# Autodesk Inventor assembly: 4 CYLINDER ENGINE ASSEMBLY
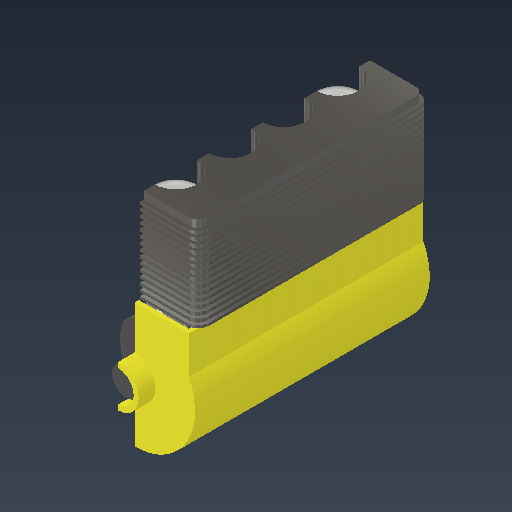
[picture p0: Inventor's stored thumbnail of the model, 512x512]
Saved by Autodesk Inventor 2026.1 (Build 301233020, 233B)
## iProperties
Created: 2026-10-10
Part Number: 4 CYLINDER ENGINE ASSEMBLY
Document SubType Name: Assembly
Designer: ADMIN
Author: ADMIN
## Documents named in this file (7)
- C:\Users\ADMIN\Desktop\4 cylinder Engine Design\4 CYLINDER ENGINE ASSEMBLY.iam
- C:\Users\ADMIN\Desktop\4 cylinder Engine Design\LOWER BLOCK.ipt
- C:\Users\ADMIN\Desktop\4 cylinder Engine Design\ENGINE BLOCK.ipt
- C:\Users\ADMIN\Desktop\4 cylinder Engine Design\CRANK SHAFT.ipt
- C:\Users\ADMIN\Desktop\4 cylinder Engine Design\PISTON.ipt
- C:\Users\ADMIN\Desktop\4 cylinder Engine Design\PISTON PIN.ipt
- C:\Users\ADMIN\Desktop\4 cylinder Engine Design\CONNECTING ROD.ipt
## Components (15 placed, 6 different names)
1. LOWER BLOCK:1 — Flush:1, Flush:2, Flush:3, Mate:1, Flush:4, Flush:5, Mate:2, Flush:6
2. ENGINE BLOCK:1 — Mate:1, Flush:4, Flush:5, Mate:16, Mate:18, Mate:20, Mate:22
3. CRANK SHAFT:1 — Mate:2, Flush:6, Mate:15, Mate:17, Mate:19, Mate:21
4. PISTON:1 — Flush:7, Mate:3, Mate:5, Mate:18
5. PISTON PIN:1 — Flush:7, Mate:3, Mate:4
6. CONNECTING ROD:1 — Mate:4, Mate:5, Mate:17
7. PISTON:2 — Mate:22
8. PISTON PIN:2
9. CONNECTING ROD:2 — Mate:21
10. PISTON:3 — Mate:20
11. PISTON PIN:3
12. CONNECTING ROD:3 — Mate:19
13. PISTON:4 — Mate:16
14. PISTON PIN:4
15. CONNECTING ROD:4 — Mate:15
## Relationships (32: Mate 22, Flush 10)
- Flush:1: LOWER BLOCK:1
- Flush:2: LOWER BLOCK:1
- Flush:3: LOWER BLOCK:1
- Mate:1: LOWER BLOCK:1 ↔ ENGINE BLOCK:1
- Flush:4 (1 mm): LOWER BLOCK:1 ↔ ENGINE BLOCK:1
- Flush:5: LOWER BLOCK:1 ↔ ENGINE BLOCK:1
- Mate:2: LOWER BLOCK:1 ↔ CRANK SHAFT:1
- Flush:6: LOWER BLOCK:1 ↔ CRANK SHAFT:1
- Flush:7: PISTON:1 ↔ PISTON PIN:1
- Mate:3: PISTON:1 ↔ PISTON PIN:1
- Mate:4: PISTON PIN:1 ↔ CONNECTING ROD:1
- Mate:5: PISTON:1 ↔ CONNECTING ROD:1
- [Flush]: PISTON:2 ↔ PISTON PIN:2
- [Mate]: PISTON:2 ↔ PISTON PIN:2
- [Mate]: PISTON PIN:2 ↔ CONNECTING ROD:2
- [Mate]: PISTON:2 ↔ CONNECTING ROD:2
- [Flush]: PISTON:3 ↔ PISTON PIN:3
- [Mate]: PISTON:3 ↔ PISTON PIN:3
- [Mate]: PISTON PIN:3 ↔ CONNECTING ROD:3
- [Mate]: PISTON:3 ↔ CONNECTING ROD:3
- [Flush]: PISTON:4 ↔ PISTON PIN:4
- [Mate]: PISTON:4 ↔ PISTON PIN:4
- [Mate]: PISTON PIN:4 ↔ CONNECTING ROD:4
- [Mate]: PISTON:4 ↔ CONNECTING ROD:4
- Mate:15: CRANK SHAFT:1 ↔ CONNECTING ROD:4
- Mate:16: ENGINE BLOCK:1 ↔ PISTON:4
- Mate:17: CRANK SHAFT:1 ↔ CONNECTING ROD:1
- Mate:18: ENGINE BLOCK:1 ↔ PISTON:1
- Mate:19: CRANK SHAFT:1 ↔ CONNECTING ROD:3
- Mate:20: ENGINE BLOCK:1 ↔ PISTON:3
- Mate:21: CRANK SHAFT:1 ↔ CONNECTING ROD:2
- Mate:22: ENGINE BLOCK:1 ↔ PISTON:2
## Named parameters: d12_d8 = 0 mm, d13_d9 = 0 mm, d14_d10 = 0 mm, d15_d11 = 0 mm, d16_d8 = 0 mm, d17_d9 = 0 mm, d18_d10 = 0 mm, d19_d11 = 0 mm, d20_d8 = 0 mm, d21_d9 = 0 mm, d22_d10 = 0 mm, d23_d11 = 0 mm
